# Autodesk Inventor assembly: CHAVE SECCIONADORA ROTATIVA
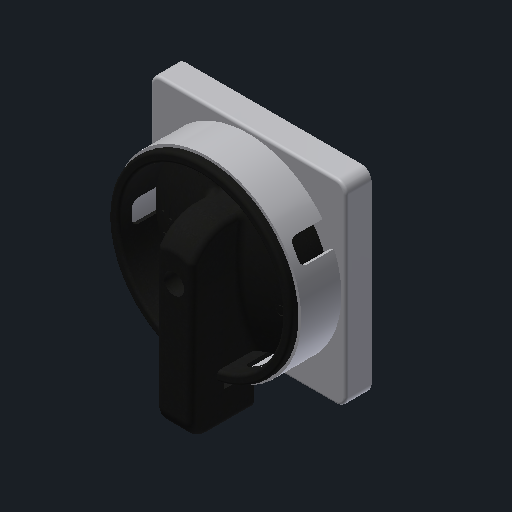
[picture p0: Inventor's stored thumbnail of the model, 512x512]
Saved by Autodesk Inventor 2022.2 (Build 262287010, 287A)
## iProperties
Created: 2020-03-19
Part Number: CHAVE SECCIONADORA ROTATIVA
Document SubType Name: Assembly
Designer: Projeto
Mass: 99.516 g
Surface Area: 370.915 cm^2
Volume: 81.3592 cm^3
Density: 1.22317 g/cm^3
Author: Projeto
## Documents named in this file (3)
- \\server\projetos\BERTOLLO\ALMOXARIFADO\Content Center Files\PECAS BERTOLLO\ELETRICA\CHAVE SECCIONADORA ROTATIVA\CHAVE SECCIONADORA ROTATIVA.iam
- \\server\projetos\BERTOLLO\ALMOXARIFADO\Content Center Files\PECAS BERTOLLO\ELETRICA\CHAVE SECCIONADORA ROTATIVA\BASE DA CHAVE.ipt
- \\server\projetos\BERTOLLO\ALMOXARIFADO\Content Center Files\PECAS BERTOLLO\ELETRICA\CHAVE SECCIONADORA ROTATIVA\CHAVE.ipt
## Components (2 placed, 2 different names)
1. BASE DA CHAVE:1 — Inserir:1
2. CHAVE:1 — Inserir:1
## Relationships (1: Insert 1)
- Inserir:1: BASE DA CHAVE:1 ↔ CHAVE:1
